# Autodesk Inventor assembly: ASY DMF-1300 Filter Package
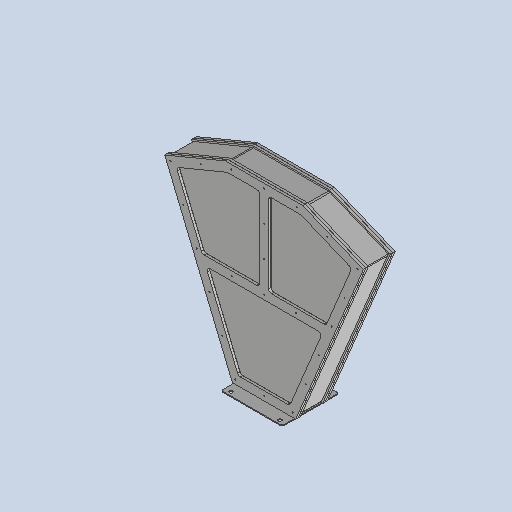
[picture p0: Inventor's stored thumbnail of the model, 512x512]
Saved by Autodesk Inventor 2026.2 (Build 302298000, 298)
## iProperties
Created: 2024-05-16
Part Number: ASY DMF-1300 Filter Package
Document SubType Name: Assembly
Designer: admin
Stock Number: DMF-1300
Author: admin
## Documents named in this file (17)
- C:\Users\admin\Documents\Inventor\DMF-Disk-Micro-Filter\Барабан v2.1\ASY DMF-1300 Filter Package.iam
- C:\Users\admin\Documents\Inventor\DMF-Disk-Micro-Filter\Барабан v2.1\DMF-1301 Outside Frame 01.ipt
- ДМС 201 Внешняя рамка.ipt
- C:\Users\admin\Documents\Inventor\DMF-Disk-Micro-Filter\Барабан v2.1\DMF-1302 Top Sheet.ipt
- C:\Users\admin\Documents\Inventor\DMF-Disk-Micro-Filter\Барабан v2.1\DMF-1303 Side Part.ipt
- C:\Users\admin\Documents\Inventor\DMF-Disk-Micro-Filter\Барабан v2.1\DMF-1304 Lower Sheet.ipt
- C:\Users\admin\Documents\Inventor\DMF-Disk-Micro-Filter\Барабан v2.1\DMF-1305 Mesh Clamp 01.ipt
- ДМС 206 Крепление сетки к кассете.ipt
- C:\Users\admin\Documents\Inventor\DMF-Disk-Micro-Filter\Барабан v2.1\DMF-1306 Cassette Mesh 01.ipt
- ДМС 207 Сетка кассеты.ipt
- C:\Users\admin\Documents\Inventor\DMF-Disk-Micro-Filter\Барабан v2.1\DMF-1307 Outside Frame 02.ipt
- C:\Users\admin\Documents\Inventor\DMF-Disk-Micro-Filter\Барабан v2.1\DMF-1308 Mesh Clamp 02.ipt
- C:\Users\admin\Documents\Inventor\DMF-Disk-Micro-Filter\Барабан v2.1\DMF-1309 Cassette Mesh 02.ipt
- C:\Users\admin\Documents\Inventor\DMF-Disk-Micro-Filter\Барабан v2.1\DMF-1202 Gear Way.ipt
- C:\Users\admin\Documents\Inventor\DMF-Disk-Micro-Filter\ContentCenter\en-US\DIN EN 24 017\ISO 4017 - M10 x 35DIN EN.ipt
- C:\Users\admin\Documents\Inventor\DMF-Disk-Micro-Filter\ContentCenter\en-US\ISO 4032(1)\ISO 4032 - M10DIN EN.ipt
- C:\Users\admin\Documents\Inventor\DMF-Disk-Micro-Filter\ContentCenter\en-US\ISO 4032(1)\ISO 4032 - M8DIN EN.ipt
## Components (16 placed, 13 different names)
1. DMF-1301 Outside Frame 01:1 — Rigid:8
2. DMF-1302 Top Sheet:1 — Rigid:7
3. DMF-1303 Side Part:1
4. DMF-1304 Lower Sheet:1 — Rigid:8, Rigid:9, Rotational:3, Rotational:4
5. DMF-1305 Mesh Clamp 01:1
6. DMF-1306 Cassette Mesh 01:1
7. DMF-1303 Side Part:2
8. DMF-1307 Outside Frame 02:1 — Rigid:7
9. DMF-1308 Mesh Clamp 02:1
10. DMF-1309 Cassette Mesh 02:1
11. DMF-1202 Gear Way:1 — Mate:4, Mate:5, Rigid:9, Mate:6, Mate:8, Insert:5
12. ISO 4017 - M10 x 35DIN EN:1 — Rotational:3, Mate:7
13. ISO 4017 - M10 x 35DIN EN:2 — Rotational:4
14. ISO 4032 - M10DIN EN:1 — Mate:7, Mate:8
15. ISO 4032 - M10DIN EN:2
16. ISO 4032 - M8DIN EN:1 — Insert:5
## Relationships (21: WeldJoint 8, Mate 7, RevoluteJoint 4, Insert 2)
- [WeldJoint]: DMF-1301 Outside Frame 01:1 ↔ DMF-1306 Cassette Mesh 01:1
- [WeldJoint]: DMF-1301 Outside Frame 01:1 ↔ DMF-1302 Top Sheet:1
- [RevoluteJoint]: DMF-1301 Outside Frame 01:1 ↔ DMF-1303 Side Part:1
- [Mate]: DMF-1301 Outside Frame 01:1 ↔ DMF-1303 Side Part:1
- [WeldJoint] (0.5 mm): DMF-1301 Outside Frame 01:1 ↔ DMF-1305 Mesh Clamp 01:1
- [RevoluteJoint]: DMF-1301 Outside Frame 01:1 ↔ DMF-1303 Side Part:2
- [Mate]: DMF-1301 Outside Frame 01:1 ↔ DMF-1303 Side Part:2
- [WeldJoint] (0.5 mm): DMF-1307 Outside Frame 02:1 ↔ DMF-1308 Mesh Clamp 02:1
- [WeldJoint]: DMF-1307 Outside Frame 02:1 ↔ DMF-1309 Cassette Mesh 02:1
- Rigid:7 [WeldJoint]: DMF-1302 Top Sheet:1 ↔ DMF-1307 Outside Frame 02:1
- Rigid:8 [WeldJoint]: DMF-1301 Outside Frame 01:1 ↔ DMF-1304 Lower Sheet:1
- Mate:4: DMF-1202 Gear Way:1
- Mate:5: DMF-1202 Gear Way:1
- Rigid:9 [WeldJoint] (5 mm): DMF-1304 Lower Sheet:1 ↔ DMF-1202 Gear Way:1
- Mate:6: DMF-1202 Gear Way:1
- Rotational:3 [RevoluteJoint]: DMF-1304 Lower Sheet:1 ↔ ISO 4017 - M10 x 35DIN EN:1
- Rotational:4 [RevoluteJoint]: DMF-1304 Lower Sheet:1 ↔ ISO 4017 - M10 x 35DIN EN:2
- Mate:7: ISO 4017 - M10 x 35DIN EN:1 ↔ ISO 4032 - M10DIN EN:1
- Mate:8: DMF-1202 Gear Way:1 ↔ ISO 4032 - M10DIN EN:1
- [Insert]: DMF-1202 Gear Way:1 ↔ ISO 4032 - M10DIN EN:2
- Insert:5: DMF-1202 Gear Way:1 ↔ ISO 4032 - M8DIN EN:1
## Named parameters: d0_d1 = 0 mm, d1_d3 = 0 mm, d2_d4 = 0 mm, d3_d5 = 90 deg, d4_d6 = 0 mm, d5_d7 = 0.5 mm, d6_d8 = 0 mm, d7_d9 = -90 deg, d8_d10 = 0 mm
